# Autodesk Inventor assembly: ENSAMBLE2
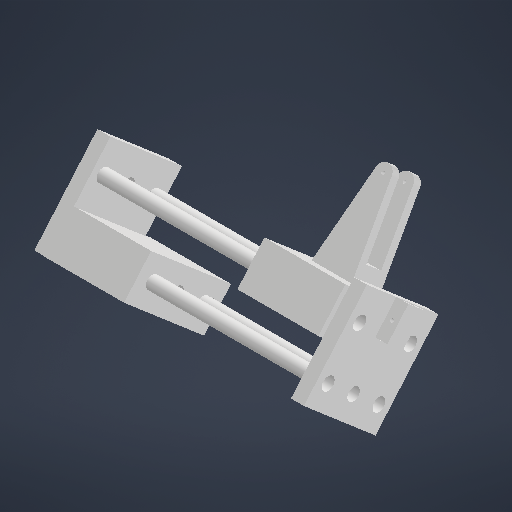
[picture p0: Inventor's stored thumbnail of the model, 512x512]
Saved by Autodesk Inventor 2027.1 (Build 311270010, 270A)
## iProperties
Created: 2026-11-03
Part Number: ENSAMBLE2
Document SubType Name: Assembly
Designer: MANGEL
Author: MANGEL
## Documents named in this file (6)
- C:\Users\MANGEL\Desktop\Brazo 4GL\ENSAMBLE2.iam
- C:\Users\MANGEL\Desktop\Brazo 4GL\soporteCorrederas.ipt
- C:\Users\MANGEL\Desktop\Brazo 4GL\barraDesliz.ipt
- C:\Users\MANGEL\Desktop\Brazo 4GL\BaseRodilloY.ipt
- C:\Users\MANGEL\Desktop\Brazo 4GL\soporteBarrasBrazo.ipt
- C:\Users\MANGEL\Desktop\Brazo 4GL\Pieza14.ipt
## Components (10 placed, 5 different names)
1. soporteCorrederas:1 — Coincidencia:1, Nivelación:1, Nivelación:2, Insertar:1, Insertar:2, Insertar:3, Insertar:4
2. soporteCorrederas:2 — Coincidencia:1, Nivelación:1, Nivelación:2, Coincidencia:5, Nivelación:3
3. barraDesliz:1 — Insertar:1, Insertar:8
4. barraDesliz:2 — Insertar:3, Insertar:6
5. barraDesliz:3 — Insertar:4, Insertar:7
6. barraDesliz:4 — Insertar:2, Insertar:5
7. BaseRodilloY:1 — Insertar:5, Insertar:6, Coincidencia:2, Coincidencia:3, Coincidencia:4
8. BaseRodilloY:2 — Insertar:7, Insertar:8
9. soporteBarrasBrazo:1 — Coincidencia:2, Coincidencia:3, Coincidencia:4
10. Pieza14:1 — Coincidencia:5, Nivelación:3
## Relationships (16: Insert 8, Mate 5, Flush 3)
- Coincidencia:1 [Mate] (302 mm): soporteCorrederas:1 ↔ soporteCorrederas:2
- Nivelación:1 [Flush]: soporteCorrederas:1 ↔ soporteCorrederas:2
- Nivelación:2 [Flush]: soporteCorrederas:1 ↔ soporteCorrederas:2
- Insertar:1: soporteCorrederas:1 ↔ barraDesliz:1
- Insertar:2: soporteCorrederas:1 ↔ barraDesliz:4
- Insertar:3: soporteCorrederas:1 ↔ barraDesliz:2
- Insertar:4: soporteCorrederas:1 ↔ barraDesliz:3
- Insertar:5: barraDesliz:4 ↔ BaseRodilloY:1
- Insertar:6: barraDesliz:2 ↔ BaseRodilloY:1
- Insertar:7: barraDesliz:3 ↔ BaseRodilloY:2
- Insertar:8: barraDesliz:1 ↔ BaseRodilloY:2
- Coincidencia:2 [Mate]: BaseRodilloY:1 ↔ soporteBarrasBrazo:1
- Coincidencia:3 [Mate] (41.2 mm): BaseRodilloY:1 ↔ soporteBarrasBrazo:1
- Coincidencia:4 [Mate] (25.1 mm): BaseRodilloY:1 ↔ soporteBarrasBrazo:1
- Coincidencia:5 [Mate]: soporteCorrederas:2 ↔ Pieza14:1
- Nivelación:3 [Flush]: soporteCorrederas:2 ↔ Pieza14:1
